# Autodesk Inventor assembly: ASY DMF-1000 Drum
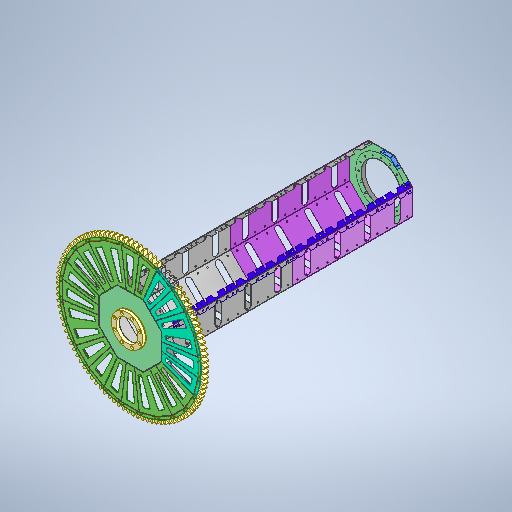
[picture p0: Inventor's stored thumbnail of the model, 512x512]
Saved by Autodesk Inventor 2026.2 (Build 302298000, 298)
## iProperties
Created: 2024-04-28
Part Number: ASY DMF-1000 Drum
Document SubType Name: Assembly
Designer: pokla
Stock Number: DMF-1000
Author: pokla
## Documents named in this file (16)
- C:\Users\admin\Documents\Inventor\DMF-Disk-Micro-Filter\Барабан v2.1\ASY DMF-1000 Drum.iam
- C:\Users\admin\Documents\Inventor\DMF-Disk-Micro-Filter\Барабан v2.1\DMF-1003 Drum Sheet Left Side.ipt
- C:\Users\admin\Documents\Inventor\DMF-Disk-Micro-Filter\Барабан v2.1\DMF-1004 Drum Sheet Right Side.ipt
- C:\Users\admin\Documents\Inventor\DMF-Disk-Micro-Filter\Барабан v2.1\DMF-1009 Support Ring Bow.ipt
- C:\Users\admin\Documents\Inventor\DMF-Disk-Micro-Filter\Барабан v2.1\DMF-1006 Cap Support.ipt
- C:\Users\admin\Documents\Inventor\DMF-Disk-Micro-Filter\Барабан v2.1\DMF-0011 Dimensions.ipt
- C:\Users\admin\Documents\Inventor\DMF-Disk-Micro-Filter\Барабан v2.1\ASY DMF-1200 Gear Cap.iam
- C:\Users\admin\Documents\Inventor\DMF-Disk-Micro-Filter\Барабан v2.1\DMF-1010 Support Ring Stern.ipt
- C:\Users\admin\Documents\Inventor\DMF-Disk-Micro-Filter\Барабан v2.1\DMF-1008 Drum End Stern.ipt
- C:\Users\admin\Documents\Inventor\DMF-Disk-Micro-Filter\Барабан v2.1\ASY DMF-1300 Filter Package.iam
- C:\Users\admin\Documents\Inventor\DMF-Disk-Micro-Filter\Барабан v2.1\DMF-1001 Cylinder Sheet Cap.ipt
- C:\Users\admin\Documents\Inventor\DMF-Disk-Micro-Filter\ContentCenter\en-US\DIN 913\DIN 913 - M12 x 20.ipt
- C:\Users\admin\Documents\Inventor\DMF-Disk-Micro-Filter\Барабан v2.1\DMF-1014 Drum Sheet Left Side Long.ipt
- C:\Users\admin\Documents\Inventor\DMF-Disk-Micro-Filter\Барабан v2.1\DMF-1002 Drum Sheet.ipt
- C:\Users\admin\Documents\Inventor\DMF-Disk-Micro-Filter\Барабан v2.1\DMF-1015 Cap Bracket Large.ipt
- C:\Users\admin\Documents\Inventor\DMF-Disk-Micro-Filter\Барабан v2.1\DMF-1007 Drum End Bow.ipt
## Components (31 placed, 15 different names)
1. DMF-0011 Dimensions:1
2. DMF-1009 Support Ring Bow:1
3. DMF-1010 Support Ring Stern:1 — Rigid:14
4. DMF-1008 Drum End Stern:1 — Rigid:13, Rigid:14, Mate:7, Mate:10
5. DMF-1003 Drum Sheet Left Side:1 — Rigid:3
6. DMF-1004 Drum Sheet Right Side:1 — Mate:10
7. DMF-1006 Cap Support:1 — Rigid:12, Mate:8
8. DMF-1001 Cylinder Sheet Cap:1 — Rigid:2, Mate:7, Mate:8, Mate:9
9. DMF-1003 Drum Sheet Left Side:2 — Rigid:4, Rigid:13
10. DMF-1006 Cap Support:2 — Rigid:12, Mate:1, Mate:3, Mate:18, Mate:21
11. DIN 913 - M12 x 20:1
12. DMF-1001 Cylinder Sheet Cap:2 — Rigid:2, Mate:18, Mate:19, Mate:22
13. ASY DMF-1200 Gear Cap:1 [sub-assembly] — Mate:15, Mate:16, Flush:2
14. ASY DMF-1200 Gear Cap:2 [sub-assembly]
15. ASY DMF-1200 Gear Cap:3 [sub-assembly]
16. ASY DMF-1200 Gear Cap:4 [sub-assembly] — Mate:13, Mate:14, Flush:1
17. DMF-1007 Drum End Bow:1 — Flush:1, Flush:2, Flush:3, Flush:4, Mate:17
18. DMF-1014 Drum Sheet Left Side Long:1 — Rigid:3, Mate:5, Mate:14
19. DMF-1014 Drum Sheet Left Side Long:2 — Rigid:4, Mate:1, Mate:16
20. DMF-1002 Drum Sheet:1 — Mate:3, Mate:11, Mate:12, Mate:13, Mate:15, Flush:3, Flush:4, Mate:17, Mate:20, Mate:21, Mate:22
21. DMF-1006 Cap Support:5 — Rigid:17, Mate:9
22. DMF-1006 Cap Support:6 — Mate:5, Rigid:17, Mate:19, Mate:20
23. DMF-1015 Cap Bracket Large:1 — Mate:11, Mate:12
24. ASY DMF-1300 Filter Package:1 [sub-assembly]
25. ASY DMF-1300 Filter Package:2 [sub-assembly]
26. ASY DMF-1300 Filter Package:3 [sub-assembly]
27. ASY DMF-1300 Filter Package:4 [sub-assembly]
28. ASY DMF-1300 Filter Package:5 [sub-assembly]
29. ASY DMF-1300 Filter Package:6 [sub-assembly]
30. ASY DMF-1300 Filter Package:7 [sub-assembly]
31. ASY DMF-1300 Filter Package:8 [sub-assembly]
## Component patterns: (8 elements, first: ASY DMF-1300 Filter Package:1)
## Relationships (33: Mate 19, WeldJoint 10, Flush 4)
- Rigid:2 [WeldJoint]: DMF-1001 Cylinder Sheet Cap:1 ↔ DMF-1001 Cylinder Sheet Cap:2
- Rigid:3 [WeldJoint]: DMF-1003 Drum Sheet Left Side:1 ↔ DMF-1014 Drum Sheet Left Side Long:1
- Rigid:4 [WeldJoint]: DMF-1003 Drum Sheet Left Side:2 ↔ DMF-1014 Drum Sheet Left Side Long:2
- [WeldJoint]: DMF-1009 Support Ring Bow:1 ↔ DMF-1007 Drum End Bow:1
- [WeldJoint]: DMF-1007 Drum End Bow:1 ↔ DMF-1014 Drum Sheet Left Side Long:2
- [WeldJoint]: DMF-1007 Drum End Bow:1 ↔ DMF-1014 Drum Sheet Left Side Long:1
- Rigid:12 [WeldJoint]: DMF-1006 Cap Support:1 ↔ DMF-1006 Cap Support:2
- Mate:1: DMF-1006 Cap Support:2 ↔ DMF-1014 Drum Sheet Left Side Long:2
- Mate:3: DMF-1006 Cap Support:2 ↔ DMF-1002 Drum Sheet:1
- Rigid:13 [WeldJoint]: DMF-1008 Drum End Stern:1 ↔ DMF-1003 Drum Sheet Left Side:2
- Rigid:14 [WeldJoint]: DMF-1010 Support Ring Stern:1 ↔ DMF-1008 Drum End Stern:1
- Mate:5: DMF-1014 Drum Sheet Left Side Long:1 ↔ DMF-1006 Cap Support:6
- Rigid:17 [WeldJoint]: DMF-1006 Cap Support:5 ↔ DMF-1006 Cap Support:6
- Mate:7: DMF-1008 Drum End Stern:1 ↔ DMF-1001 Cylinder Sheet Cap:1
- Mate:8: DMF-1006 Cap Support:1 ↔ DMF-1001 Cylinder Sheet Cap:1
- Mate:9: DMF-1001 Cylinder Sheet Cap:1 ↔ DMF-1006 Cap Support:5
- Mate:10: DMF-1008 Drum End Stern:1 ↔ DMF-1004 Drum Sheet Right Side:1
- Mate:11: DMF-1002 Drum Sheet:1 ↔ DMF-1015 Cap Bracket Large:1
- Mate:12: DMF-1002 Drum Sheet:1 ↔ DMF-1015 Cap Bracket Large:1
- Mate:13: ASY DMF-1200 Gear Cap:4 ↔ DMF-1002 Drum Sheet:1
- Mate:14: ASY DMF-1200 Gear Cap:4 ↔ DMF-1014 Drum Sheet Left Side Long:1
- Flush:1: ASY DMF-1200 Gear Cap:4 ↔ DMF-1007 Drum End Bow:1
- Mate:15: ASY DMF-1200 Gear Cap:1 ↔ DMF-1002 Drum Sheet:1
- Mate:16: ASY DMF-1200 Gear Cap:1 ↔ DMF-1014 Drum Sheet Left Side Long:2
- Flush:2: ASY DMF-1200 Gear Cap:1 ↔ DMF-1007 Drum End Bow:1
- Flush:3: DMF-1007 Drum End Bow:1 ↔ DMF-1002 Drum Sheet:1
- Flush:4: DMF-1007 Drum End Bow:1 ↔ DMF-1002 Drum Sheet:1
- Mate:17: DMF-1007 Drum End Bow:1 ↔ DMF-1002 Drum Sheet:1
- Mate:18: DMF-1006 Cap Support:2 ↔ DMF-1001 Cylinder Sheet Cap:2
- Mate:19: DMF-1001 Cylinder Sheet Cap:2 ↔ DMF-1006 Cap Support:6
- Mate:20: DMF-1002 Drum Sheet:1 ↔ DMF-1006 Cap Support:6
- Mate:21: DMF-1006 Cap Support:2 ↔ DMF-1002 Drum Sheet:1
- Mate:22: DMF-1001 Cylinder Sheet Cap:2 ↔ DMF-1002 Drum Sheet:1
